# Autodesk Inventor assembly: PCB-A 1
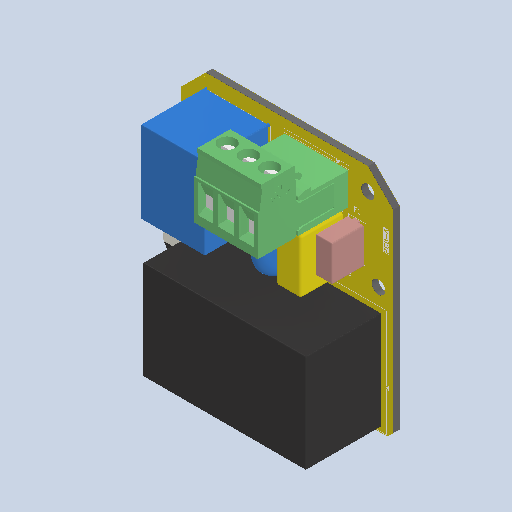
[picture p0: Inventor's stored thumbnail of the model, 512x512]
Saved by Autodesk Inventor 2025.2 (Build 292293000, 293)
## iProperties
Created: 2026-06-16
Part Number: PCB-A 1
Description: KiCad electronic assembly
Document SubType Name: Assembly
Designer: AdminForWorker
Title: PCB-A v1
Author: AdminForWorker
## Documents named in this file (21)
- D:\GITHUB\esp32-based-iot-switch\CAD\PCB-A\PCB-A.iam
- D:\GITHUB\esp32-based-iot-switch\CAD\PCB-A\2EDGV-5_08-03P-1Y-100A&Z(H).ipt
- D:\GITHUB\esp32-based-iot-switch\CAD\PCB-A\2EDGK-5.08-03P-14-1000A&Z(H).ipt
- D:\GITHUB\esp32-based-iot-switch\CAD\PCB-A\FUSE_littlefuse.ipt
- D:\GITHUB\esp32-based-iot-switch\CAD\PCB-A\CP_Elec_6.3x5.4.ipt
- D:\GITHUB\esp32-based-iot-switch\CAD\PCB-A\SOT-23.ipt
- D:\GITHUB\esp32-based-iot-switch\CAD\PCB-A\D_SOD-123.ipt
- D:\GITHUB\esp32-based-iot-switch\CAD\PCB-A\RV_Disc_D12mm_W4.3mm_P7.5mm.ipt
- D:\GITHUB\esp32-based-iot-switch\CAD\PCB-A\R_0805_2012Metric.ipt
- D:\GITHUB\esp32-based-iot-switch\CAD\PCB-A\C_Rect_L13.0mm_W6.0mm_P10.00mm_FKS3_FKP3_MKS4.ipt
- D:\GITHUB\esp32-based-iot-switch\CAD\PCB-A\LED_1206_3216Metric.ipt
- D:\GITHUB\esp32-based-iot-switch\CAD\PCB-A\Relay_SPST_SANYOU_SRD_Series_Form_A.ipt
- D:\GITHUB\esp32-based-iot-switch\CAD\PCB-A\Converter_ACDC_Hi-Link_HLK-5Mxx.ipt
- D:\GITHUB\esp32-based-iot-switch\CAD\PCB-A\PinSocket_2x03_P2.54mm_Vertical_SMD.ipt
- D:\GITHUB\esp32-based-iot-switch\CAD\PCB-A\ESP32C5_iot_switch_copper.ipt
- D:\GITHUB\esp32-based-iot-switch\CAD\PCB-A\ESP32C5_iot_switch_pad.ipt
- D:\GITHUB\esp32-based-iot-switch\CAD\PCB-A\ESP32C5_iot_switch_silkscreen.ipt
- D:\GITHUB\esp32-based-iot-switch\CAD\PCB-A\ESP32C5_iot_switch_silkscreen (1).ipt
- D:\GITHUB\esp32-based-iot-switch\CAD\PCB-A\ESP32C5_iot_switch_soldermask.ipt
- D:\GITHUB\esp32-based-iot-switch\CAD\PCB-A\ESP32C5_iot_switch_soldermask (1).ipt
- D:\GITHUB\esp32-based-iot-switch\CAD\PCB-A\ESP32C5_iot_switch_PCB.ipt
## Components (22 placed, 20 different names)
1. 2EDGV-5_08-03P-1Y-100A&Z(H):1
2. 2EDGK-5.08-03P-14-1000A&Z(H):1
3. FUSE_littlefuse:1
4. CP_Elec_6.3x5.4:1
5. SOT-23:1
6. D_SOD-123:1
7. RV_Disc_D12mm_W4.3mm_P7.5mm:1
8. R_0805_2012Metric:1
9. C_Rect_L13.0mm_W6.0mm_P10.00mm_FKS3_FKP3_MKS4:1
10. LED_1206_3216Metric:1
11. Relay_SPST_SANYOU_SRD_Series_Form_A:1
12. Converter_ACDC_Hi-Link_HLK-5Mxx:1
13. PinSocket_2x03_P2.54mm_Vertical_SMD:1
14. ESP32C5_iot_switch_copper:1
15. ESP32C5_iot_switch_pad:1
16. ESP32C5_iot_switch_silkscreen:1
17. ESP32C5_iot_switch_silkscreen (1):1
18. ESP32C5_iot_switch_soldermask:1
19. ESP32C5_iot_switch_soldermask (1):1
20. ESP32C5_iot_switch_PCB:1
21. R_0805_2012Metric:2
22. R_0805_2012Metric:3
## Named parameters: Finish1_Area = 25.082, Finish2_Area = 23.7164
note: some values were not read from the file. Shown as the stored number, unit unknown: "Finish1_Area", "Finish2_Area".
